# Autodesk Inventor assembly: Roda
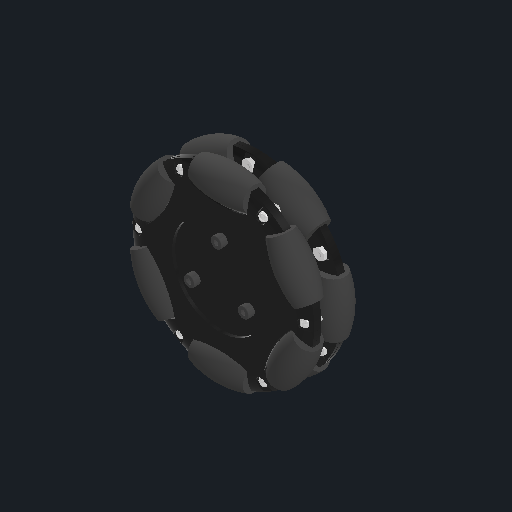
[picture p0: Inventor's stored thumbnail of the model, 512x512]
Saved by Autodesk Inventor 2026.1 (Build 301233000, 233)
## iProperties
Created: 2025-01-03
Part Number: Roda
Document SubType Name: Assembly
Designer: Cliente
Mass: 284.252 g
Surface Area: 1246.6 cm^2
Volume: 278.111 cm^3
Density: 1.02208 g/cm^3
Author: Cliente
## Documents named in this file (16)
- C:\Users\Cliente\Desktop\TCC\Base\Roda\Roda.iam
- C:\Users\Cliente\Desktop\TCC\Base\Roda\Espaçador roda.ipt
- C:\Users\Cliente\Desktop\TCC\Base\Roda\Tampa roda (porca - frente).ipt
- C:\Users\Cliente\Desktop\TCC\Base\Roda\Eixo (rebite).ipt
- C:\Users\Cliente\Desktop\TCC\Base\Roda\Rolete.ipt
- C:\Users\Cliente\Desktop\TCC\Base\Roda\Tampa roda (parafuso - frente).ipt
- C:\Users\Cliente\Desktop\TCC\Base\Roda\Tampa roda (porca - trás).ipt
- C:\Users\Cliente\Desktop\TCC\Base\Roda\Tampa roda (parafuso - trás).ipt
- C:\Users\Cliente\Desktop\TCC\Base\Roda\Peça5.ipt
- C:\Users\Cliente\Desktop\TCC\Base\Fixação\Porca 2,9mm.ipt
- C:\Users\Cliente\Desktop\TCC\Base\Fixação\Parafuso 2,9 x 8mm.ipt
- C:\Users\Cliente\Desktop\TCC\Base\Roda\Acoplamento motor roda.ipt
- C:\Users\Cliente\Desktop\TCC\Base\Fixação\Parafuso allen cabeça cilíndrica DIN 912 M4x30.ipt
- C:\Users\Cliente\Desktop\TCC\Base\Fixação\Porca sextavada DIN 934 M4.ipt
- C:\Users\Cliente\Desktop\TCC\Base\Fixação\Parafuso 2,5 x 20mm.ipt
- C:\Users\Cliente\Desktop\TCC\Base\Fixação\Porca 2,5mm.ipt
## Components (63 placed, 15 different names)
1. Espaçador roda:1 — Alinhado:1, Alinhado:2, Alinhado:3, Coincidente:1, Coincidente:2, Coincidente:3, Coincidente:10, Coincidente:11, Coincidente:12
2. Tampa roda (porca - frente):1 — Coincidente:1, Coincidente:2, Coincidente:3, Coincidente:4, Coincidente:5, Coincidente:7, Coincidente:8, Coincidente:9, Coincidente:25, Ângulo:2
3. Tampa roda (parafuso - frente):1 — Coincidente:7, Coincidente:8, Coincidente:9, Coincidente:19, Coincidente:26, Coincidente:29, Coincidente:30, Ângulo:4, Coincidente:34, Coincidente:35
4. Tampa roda (porca - trás):1 — Coincidente:10, Coincidente:11, Coincidente:12, Coincidente:13, Coincidente:14, Coincidente:16, Coincidente:17, Coincidente:18, Coincidente:20, Coincidente:23, Ângulo:1
5. Tampa roda (parafuso - trás):1 — Coincidente:16, Coincidente:17, Coincidente:18, Coincidente:24, Coincidente:27, Coincidente:28, Ângulo:3, Coincidente:31, Coincidente:32, Coincidente:33
6. Peça5:1 — Alinhado:6, Alinhado:7
7. Acoplamento motor roda:1 — Coincidente:31, Coincidente:32, Coincidente:33, Ângulo:5, Coincidente:36, Ângulo:6, Coincidente:38, Coincidente:39, Ângulo:7, Coincidente:40, Ângulo:8
8. Parafuso 2,5 x 20mm:1 — Coincidente:38, Coincidente:39, Ângulo:7, Coincidente:41
9. Porca 2,5mm:1 — Coincidente:40, Coincidente:41, Ângulo:8
10. Rolete:1 — Coincidente:6, Alinhado:4
11. Eixo (rebite):1 — Coincidente:4, Coincidente:5, Coincidente:6, Alinhado:4
12. Rolete:2
13. Eixo (rebite):2
14. Rolete:3
15. Eixo (rebite):3
16. Rolete:4
17. Eixo (rebite):4
18. Rolete:5
19. Eixo (rebite):5
20. Rolete:6
21. Eixo (rebite):6
22. Rolete:7 — Coincidente:15, Alinhado:5
23. Eixo (rebite):7 — Coincidente:13, Coincidente:14, Coincidente:15, Alinhado:5
24. Rolete:8
25. Eixo (rebite):8
26. Rolete:9
27. Eixo (rebite):9
28. Rolete:10
29. Eixo (rebite):10
30. Rolete:11
31. Eixo (rebite):11
32. Rolete:12
33. Eixo (rebite):12
34. Porca 2,9mm:1 — Coincidente:23, Coincidente:24, Ângulo:1
35. Parafuso 2,9 x 8mm:1 — Coincidente:27, Coincidente:28, Ângulo:3
36. Porca 2,9mm:3
37. Parafuso 2,9 x 8mm:3
38. Porca 2,9mm:4
39. Parafuso 2,9 x 8mm:4
40. Porca 2,9mm:5
41. Parafuso 2,9 x 8mm:5
42. Porca 2,9mm:6
43. Parafuso 2,9 x 8mm:6
44. Porca 2,9mm:7
45. Parafuso 2,9 x 8mm:7
46. Parafuso 2,9 x 8mm:2 — Coincidente:29, Coincidente:30, Ângulo:4
47. Porca 2,9mm:2 — Coincidente:25, Coincidente:26, Ângulo:2
48. Parafuso 2,9 x 8mm:8
49. Porca 2,9mm:8
50. Parafuso 2,9 x 8mm:9
51. Porca 2,9mm:9
52. Parafuso 2,9 x 8mm:10
53. Porca 2,9mm:10
54. Parafuso 2,9 x 8mm:11
55. Porca 2,9mm:11
56. Parafuso 2,9 x 8mm:12
57. Porca 2,9mm:12
58. Parafuso allen cabeça cilíndrica DIN 912 M4x30:1 — Coincidente:34, Coincidente:35, Ângulo:5, Coincidente:37
59. Porca sextavada DIN 934 M4:1 — Coincidente:36, Coincidente:37, Ângulo:6
60. Parafuso allen cabeça cilíndrica DIN 912 M4x30:2
61. Porca sextavada DIN 934 M4:2
62. Parafuso allen cabeça cilíndrica DIN 912 M4x30:3
63. Porca sextavada DIN 934 M4:3
## Component patterns: (6 elements, first: Rolete:1 + Eixo (rebite):1), (6 elements, first: Rolete:7 + Eixo (rebite):7), (6 elements, first: Porca 2,9mm:1 + Parafuso 2,9 x 8mm:1), (6 elements, first: Parafuso 2,9 x 8mm:2 + Porca 2,9mm:2), (3 elements, first: Parafuso allen cabeça cilíndrica DIN 912 M4x30:1 + Porca sextavada DIN 934 M4:1)
## Relationships (56: Mate 41, Angle 8, Flush 7)
- Alinhado:1 [Flush]: Espaçador roda:1
- Alinhado:2 [Flush]: Espaçador roda:1
- Alinhado:3 [Flush]: Espaçador roda:1
- Coincidente:1 [Mate]: Espaçador roda:1 ↔ Tampa roda (porca - frente):1
- Coincidente:2 [Mate]: Espaçador roda:1 ↔ Tampa roda (porca - frente):1
- Coincidente:3 [Mate]: Espaçador roda:1 ↔ Tampa roda (porca - frente):1
- Coincidente:4 [Mate]: Tampa roda (porca - frente):1 ↔ Eixo (rebite):1
- Coincidente:5 [Mate] (0.15 mm): Tampa roda (porca - frente):1 ↔ Eixo (rebite):1
- Coincidente:6 [Mate]: Rolete:1 ↔ Eixo (rebite):1
- Alinhado:4 [Flush]: Rolete:1 ↔ Eixo (rebite):1
- Coincidente:7 [Mate]: Tampa roda (porca - frente):1 ↔ Tampa roda (parafuso - frente):1
- Coincidente:8 [Mate]: Tampa roda (porca - frente):1 ↔ Tampa roda (parafuso - frente):1
- Coincidente:9 [Mate]: Tampa roda (porca - frente):1 ↔ Tampa roda (parafuso - frente):1
- Coincidente:10 [Mate]: Espaçador roda:1 ↔ Tampa roda (porca - trás):1
- Coincidente:11 [Mate]: Espaçador roda:1 ↔ Tampa roda (porca - trás):1
- Coincidente:12 [Mate]: Espaçador roda:1 ↔ Tampa roda (porca - trás):1
- Coincidente:13 [Mate]: Tampa roda (porca - trás):1 ↔ Eixo (rebite):7
- Coincidente:14 [Mate] (0.15 mm): Tampa roda (porca - trás):1 ↔ Eixo (rebite):7
- Coincidente:15 [Mate]: Rolete:7 ↔ Eixo (rebite):7
- Alinhado:5 [Flush]: Rolete:7 ↔ Eixo (rebite):7
- Coincidente:16 [Mate]: Tampa roda (porca - trás):1 ↔ Tampa roda (parafuso - trás):1
- Coincidente:17 [Mate]: Tampa roda (porca - trás):1 ↔ Tampa roda (parafuso - trás):1
- Coincidente:18 [Mate]: Tampa roda (porca - trás):1 ↔ Tampa roda (parafuso - trás):1
- Coincidente:19 [Mate]: Tampa roda (parafuso - frente):1
- Coincidente:20 [Mate]: Tampa roda (porca - trás):1
- Coincidente:21 [Mate]
- Coincidente:22 [Mate]
- Alinhado:6 [Flush]: Peça5:1
- Alinhado:7 [Flush]: Peça5:1
- Coincidente:23 [Mate]: Tampa roda (porca - trás):1 ↔ Porca 2,9mm:1
- Coincidente:24 [Mate]: Tampa roda (parafuso - trás):1 ↔ Porca 2,9mm:1
- Ângulo:1 [Angle] (0 deg): Tampa roda (porca - trás):1 ↔ Porca 2,9mm:1
- Coincidente:25 [Mate]: Tampa roda (porca - frente):1 ↔ Porca 2,9mm:2
- Coincidente:26 [Mate]: Tampa roda (parafuso - frente):1 ↔ Porca 2,9mm:2
- Ângulo:2 [Angle] (0 deg): Tampa roda (porca - frente):1 ↔ Porca 2,9mm:2
- Coincidente:27 [Mate]: Tampa roda (parafuso - trás):1 ↔ Parafuso 2,9 x 8mm:1
- Coincidente:28 [Mate]: Tampa roda (parafuso - trás):1 ↔ Parafuso 2,9 x 8mm:1
- Ângulo:3 [Angle] (90 deg): Tampa roda (parafuso - trás):1 ↔ Parafuso 2,9 x 8mm:1
- Coincidente:29 [Mate]: Tampa roda (parafuso - frente):1 ↔ Parafuso 2,9 x 8mm:2
- Coincidente:30 [Mate]: Tampa roda (parafuso - frente):1 ↔ Parafuso 2,9 x 8mm:2
- Ângulo:4 [Angle] (90 deg): Tampa roda (parafuso - frente):1 ↔ Parafuso 2,9 x 8mm:2
- Coincidente:31 [Mate]: Tampa roda (parafuso - trás):1 ↔ Acoplamento motor roda:1
- Coincidente:32 [Mate]: Tampa roda (parafuso - trás):1 ↔ Acoplamento motor roda:1
- Coincidente:33 [Mate]: Tampa roda (parafuso - trás):1 ↔ Acoplamento motor roda:1
- Coincidente:34 [Mate]: Tampa roda (parafuso - frente):1 ↔ Parafuso allen cabeça cilíndrica DIN 912 M4x30:1
- Coincidente:35 [Mate]: Tampa roda (parafuso - frente):1 ↔ Parafuso allen cabeça cilíndrica DIN 912 M4x30:1
- Ângulo:5 [Angle] (0 deg): Acoplamento motor roda:1 ↔ Parafuso allen cabeça cilíndrica DIN 912 M4x30:1
- Coincidente:36 [Mate]: Acoplamento motor roda:1 ↔ Porca sextavada DIN 934 M4:1
- Coincidente:37 [Mate]: Parafuso allen cabeça cilíndrica DIN 912 M4x30:1 ↔ Porca sextavada DIN 934 M4:1
- Ângulo:6 [Angle] (0 deg): Acoplamento motor roda:1 ↔ Porca sextavada DIN 934 M4:1
- Coincidente:38 [Mate]: Acoplamento motor roda:1 ↔ Parafuso 2,5 x 20mm:1
- Coincidente:39 [Mate]: Acoplamento motor roda:1 ↔ Parafuso 2,5 x 20mm:1
- Ângulo:7 [Angle] (0 deg): Acoplamento motor roda:1 ↔ Parafuso 2,5 x 20mm:1
- Coincidente:40 [Mate]: Acoplamento motor roda:1 ↔ Porca 2,5mm:1
- Coincidente:41 [Mate]: Parafuso 2,5 x 20mm:1 ↔ Porca 2,5mm:1
- Ângulo:8 [Angle] (0 deg): Acoplamento motor roda:1 ↔ Porca 2,5mm:1
